# Autodesk Inventor assembly: V6_Heads_Valvetrain
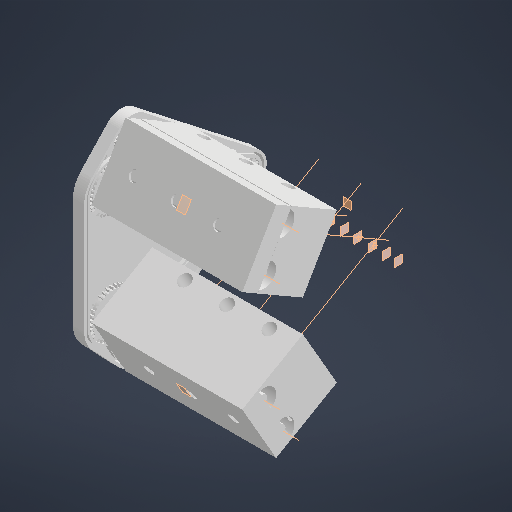
[picture p0: Inventor's stored thumbnail of the model, 512x512]
Saved by Autodesk Inventor 2027.1 (Build 311270010, 270A)
## iProperties
Created: 2026-10-17
Part Number: V6_Heads_Valvetrain
Document SubType Name: Assembly
Designer: kashyap
Author: kashyap
## Documents named in this file (20)
- C:\Users\kashyap\Documents\V6_2GR\V6_Heads_Valvetrain.iam
- C:\Users\kashyap\Documents\V6_2GR\Cylinder_Head_A.ipt
- C:\Users\kashyap\Documents\V6_2GR\Cylinder_Head_B.ipt
- C:\Users\kashyap\Documents\V6_2GR\Cam_Cover_A.ipt
- C:\Users\kashyap\Documents\V6_2GR\Cam_Cover_B.ipt
- C:\Users\kashyap\Documents\V6_2GR\Timing_Cover.ipt
- C:\Users\kashyap\Documents\V6_2GR\Timing_Chain_Primary_SIMPLIFIED.ipt
- C:\Users\kashyap\Documents\V6_2GR\Timing_Chain_Secondary_A_SIMPLIFIED.ipt
- C:\Users\kashyap\Documents\V6_2GR\Timing_Chain_Secondary_B_SIMPLIFIED.ipt
- C:\Users\kashyap\Documents\V6_2GR\Chain_Guide_SIMPLIFIED.ipt
- C:\Users\kashyap\Documents\V6_2GR\Chain_Tensioner_SIMPLIFIED.ipt
- C:\Users\kashyap\Documents\V6_2GR\Intake_Valve.ipt
- C:\Users\kashyap\Documents\V6_2GR\Exhaust_Valve.ipt
- C:\Users\kashyap\Documents\V6_2GR\Camshaft_A_Intake.ipt
- C:\Users\kashyap\Documents\V6_2GR\Camshaft_A_Exhaust.ipt
- C:\Users\kashyap\Documents\V6_2GR\Camshaft_B_Intake.ipt
- C:\Users\kashyap\Documents\V6_2GR\Camshaft_B_Exhaust.ipt
- C:\Users\kashyap\Documents\V6_2GR\Crank_Sprocket.ipt
- C:\Users\kashyap\Documents\V6_2GR\Cam_Sprocket_Primary.ipt
- C:\Users\kashyap\Documents\V6_2GR\Cam_Sprocket_Secondary.ipt
## Components (45 placed, 45 different names)
1. Cylinder_Head_A — Cylinder_Head_A_Flush_X, Cylinder_Head_A_Flush_Y, Cylinder_Head_A_Flush_Z, Valve_A1_IN_F_on_Axis, Valve_A1_IN_F_Seat_Mate, Valve_A1_IN_R_on_Axis, Valve_A1_IN_R_Seat_Mate, Valve_A1_EX_F_on_Axis, Valve_A1_EX_F_Seat_Mate, Valve_A1_EX_R_on_Axis, Valve_A1_EX_R_Seat_Mate, Valve_A2_IN_F_on_Axis, Valve_A2_IN_F_Seat_Mate_LIFT_AT_CRANK0, Valve_A2_IN_R_on_Axis, Valve_A2_IN_R_Seat_Mate_LIFT_AT_CRANK0, Valve_A2_EX_F_on_Axis, Valve_A2_EX_F_Seat_Mate, Valve_A2_EX_R_on_Axis, Valve_A2_EX_R_Seat_Mate, Valve_A3_IN_F_on_Axis, Valve_A3_IN_F_Seat_Mate, Valve_A3_IN_R_on_Axis, Valve_A3_IN_R_Seat_Mate, Valve_A3_EX_F_on_Axis, Valve_A3_EX_F_Seat_Mate_LIFT_AT_CRANK0, Valve_A3_EX_R_on_Axis, Valve_A3_EX_R_Seat_Mate_LIFT_AT_CRANK0, Camshaft_A_Intake_on_Cam_Axis, Camshaft_A_Intake_Phase_Angle_ASSUMED, Camshaft_A_Exhaust_on_Cam_Axis, Camshaft_A_Exhaust_Phase_Angle_ASSUMED
2. Cylinder_Head_B — Cylinder_Head_B_Flush_X, Cylinder_Head_B_Flush_Y, Cylinder_Head_B_Flush_Z, Valve_B1_IN_F_on_Axis, Valve_B1_IN_F_Seat_Mate, Valve_B1_IN_R_on_Axis, Valve_B1_IN_R_Seat_Mate, Valve_B1_EX_F_on_Axis, Valve_B1_EX_F_Seat_Mate, Valve_B1_EX_R_on_Axis, Valve_B1_EX_R_Seat_Mate, Valve_B2_IN_F_on_Axis, Valve_B2_IN_F_Seat_Mate, Valve_B2_IN_R_on_Axis, Valve_B2_IN_R_Seat_Mate, Valve_B2_EX_F_on_Axis, Valve_B2_EX_F_Seat_Mate, Valve_B2_EX_R_on_Axis, Valve_B2_EX_R_Seat_Mate, Valve_B3_IN_F_on_Axis, Valve_B3_IN_F_Seat_Mate, Valve_B3_IN_R_on_Axis, Valve_B3_IN_R_Seat_Mate, Valve_B3_EX_F_on_Axis, Valve_B3_EX_F_Seat_Mate, Valve_B3_EX_R_on_Axis, Valve_B3_EX_R_Seat_Mate, Camshaft_B_Intake_on_Cam_Axis, Camshaft_B_Intake_Phase_Angle_ASSUMED, Camshaft_B_Exhaust_on_Cam_Axis, Camshaft_B_Exhaust_Phase_Angle_ASSUMED
3. Cam_Cover_A — Cam_Cover_A_Flush_X, Cam_Cover_A_Flush_Y, Cam_Cover_A_Flush_Z
4. Cam_Cover_B — Cam_Cover_B_Flush_X, Cam_Cover_B_Flush_Y, Cam_Cover_B_Flush_Z
5. Timing_Cover — Timing_Cover_Flush_X, Timing_Cover_Flush_Y, Timing_Cover_Flush_Z, Crank_Sprocket_on_Axis, Crank_Sprocket_Plane_Flush, Cam_Sprocket_Primary_A_Plane_Flush, Cam_Sprocket_Secondary_A_Intake_Plane_Flush, Cam_Sprocket_Secondary_A_Exhaust_Plane_Flush, Cam_Sprocket_Primary_B_Plane_Flush, Cam_Sprocket_Secondary_B_Intake_Plane_Flush, Cam_Sprocket_Secondary_B_Exhaust_Plane_Flush
6. Timing_Chain_Primary_SIMPLIFIED — Timing_Chain_Primary_SIMPLIFIED_Flush_X, Timing_Chain_Primary_SIMPLIFIED_Flush_Y, Timing_Chain_Primary_SIMPLIFIED_Flush_Z
7. Timing_Chain_Secondary_A_SIMPLIFIED — Timing_Chain_Secondary_A_SIMPLIFIED_Flush_X, Timing_Chain_Secondary_A_SIMPLIFIED_Flush_Y, Timing_Chain_Secondary_A_SIMPLIFIED_Flush_Z
8. Timing_Chain_Secondary_B_SIMPLIFIED — Timing_Chain_Secondary_B_SIMPLIFIED_Flush_X, Timing_Chain_Secondary_B_SIMPLIFIED_Flush_Y, Timing_Chain_Secondary_B_SIMPLIFIED_Flush_Z
9. Chain_Guide_SIMPLIFIED — Chain_Guide_SIMPLIFIED_Flush_X, Chain_Guide_SIMPLIFIED_Flush_Y, Chain_Guide_SIMPLIFIED_Flush_Z
10. Chain_Tensioner_SIMPLIFIED — Chain_Tensioner_SIMPLIFIED_Flush_X, Chain_Tensioner_SIMPLIFIED_Flush_Y, Chain_Tensioner_SIMPLIFIED_Flush_Z
11. Valve_A1_IN_F — Valve_A1_IN_F_on_Axis, Valve_A1_IN_F_Seat_Mate
12. Valve_A1_IN_R — Valve_A1_IN_R_on_Axis, Valve_A1_IN_R_Seat_Mate
13. Valve_A1_EX_F — Valve_A1_EX_F_on_Axis, Valve_A1_EX_F_Seat_Mate
14. Valve_A1_EX_R — Valve_A1_EX_R_on_Axis, Valve_A1_EX_R_Seat_Mate
15. Valve_A2_IN_F — Valve_A2_IN_F_on_Axis, Valve_A2_IN_F_Seat_Mate_LIFT_AT_CRANK0
16. Valve_A2_IN_R — Valve_A2_IN_R_on_Axis, Valve_A2_IN_R_Seat_Mate_LIFT_AT_CRANK0
17. Valve_A2_EX_F — Valve_A2_EX_F_on_Axis, Valve_A2_EX_F_Seat_Mate
18. Valve_A2_EX_R — Valve_A2_EX_R_on_Axis, Valve_A2_EX_R_Seat_Mate
19. Valve_A3_IN_F — Valve_A3_IN_F_on_Axis, Valve_A3_IN_F_Seat_Mate
20. Valve_A3_IN_R — Valve_A3_IN_R_on_Axis, Valve_A3_IN_R_Seat_Mate
21. Valve_A3_EX_F — Valve_A3_EX_F_on_Axis, Valve_A3_EX_F_Seat_Mate_LIFT_AT_CRANK0
22. Valve_A3_EX_R — Valve_A3_EX_R_on_Axis, Valve_A3_EX_R_Seat_Mate_LIFT_AT_CRANK0
23. Valve_B1_IN_F — Valve_B1_IN_F_on_Axis, Valve_B1_IN_F_Seat_Mate
24. Valve_B1_IN_R — Valve_B1_IN_R_on_Axis, Valve_B1_IN_R_Seat_Mate
25. Valve_B1_EX_F — Valve_B1_EX_F_on_Axis, Valve_B1_EX_F_Seat_Mate
26. Valve_B1_EX_R — Valve_B1_EX_R_on_Axis, Valve_B1_EX_R_Seat_Mate
27. Valve_B2_IN_F — Valve_B2_IN_F_on_Axis, Valve_B2_IN_F_Seat_Mate
28. Valve_B2_IN_R — Valve_B2_IN_R_on_Axis, Valve_B2_IN_R_Seat_Mate
29. Valve_B2_EX_F — Valve_B2_EX_F_on_Axis, Valve_B2_EX_F_Seat_Mate
30. Valve_B2_EX_R — Valve_B2_EX_R_on_Axis, Valve_B2_EX_R_Seat_Mate
31. Valve_B3_IN_F — Valve_B3_IN_F_on_Axis, Valve_B3_IN_F_Seat_Mate
32. Valve_B3_IN_R — Valve_B3_IN_R_on_Axis, Valve_B3_IN_R_Seat_Mate
33. Valve_B3_EX_F — Valve_B3_EX_F_on_Axis, Valve_B3_EX_F_Seat_Mate
34. Valve_B3_EX_R — Valve_B3_EX_R_on_Axis, Valve_B3_EX_R_Seat_Mate
35. Camshaft_A_Intake — Camshaft_A_Intake_on_Cam_Axis, Camshaft_A_Intake_Axial_Flush, Camshaft_A_Intake_Phase_Angle_ASSUMED, Cam_Sprocket_Primary_A_on_Axis, Cam_Sprocket_Primary_A_Clock, Cam_Sprocket_Secondary_A_Intake_on_Axis, Cam_Sprocket_Secondary_A_Intake_Clock
36. Camshaft_A_Exhaust — Camshaft_A_Exhaust_on_Cam_Axis, Camshaft_A_Exhaust_Axial_Flush, Camshaft_A_Exhaust_Phase_Angle_ASSUMED, Cam_Sprocket_Secondary_A_Exhaust_on_Axis, Cam_Sprocket_Secondary_A_Exhaust_Clock
37. Camshaft_B_Intake — Camshaft_B_Intake_on_Cam_Axis, Camshaft_B_Intake_Axial_Flush, Camshaft_B_Intake_Phase_Angle_ASSUMED, Cam_Sprocket_Primary_B_on_Axis, Cam_Sprocket_Primary_B_Clock, Cam_Sprocket_Secondary_B_Intake_on_Axis, Cam_Sprocket_Secondary_B_Intake_Clock
38. Camshaft_B_Exhaust — Camshaft_B_Exhaust_on_Cam_Axis, Camshaft_B_Exhaust_Axial_Flush, Camshaft_B_Exhaust_Phase_Angle_ASSUMED, Cam_Sprocket_Secondary_B_Exhaust_on_Axis, Cam_Sprocket_Secondary_B_Exhaust_Clock
39. Crank_Sprocket — Crank_Sprocket_on_Axis, Crank_Sprocket_Plane_Flush, Crank_Sprocket_Clock
40. Cam_Sprocket_Primary_A — Cam_Sprocket_Primary_A_on_Axis, Cam_Sprocket_Primary_A_Plane_Flush, Cam_Sprocket_Primary_A_Clock
41. Cam_Sprocket_Secondary_A_Intake — Cam_Sprocket_Secondary_A_Intake_on_Axis, Cam_Sprocket_Secondary_A_Intake_Plane_Flush, Cam_Sprocket_Secondary_A_Intake_Clock
42. Cam_Sprocket_Secondary_A_Exhaust — Cam_Sprocket_Secondary_A_Exhaust_on_Axis, Cam_Sprocket_Secondary_A_Exhaust_Plane_Flush, Cam_Sprocket_Secondary_A_Exhaust_Clock
43. Cam_Sprocket_Primary_B — Cam_Sprocket_Primary_B_on_Axis, Cam_Sprocket_Primary_B_Plane_Flush, Cam_Sprocket_Primary_B_Clock
44. Cam_Sprocket_Secondary_B_Intake — Cam_Sprocket_Secondary_B_Intake_on_Axis, Cam_Sprocket_Secondary_B_Intake_Plane_Flush, Cam_Sprocket_Secondary_B_Intake_Clock
45. Cam_Sprocket_Secondary_B_Exhaust — Cam_Sprocket_Secondary_B_Exhaust_on_Axis, Cam_Sprocket_Secondary_B_Exhaust_Plane_Flush, Cam_Sprocket_Secondary_B_Exhaust_Clock
## Relationships (111: Mate 59, Flush 41, Angle 11)
- Cylinder_Head_A_Flush_X [Flush]: Cylinder_Head_A
- Cylinder_Head_A_Flush_Y [Flush]: Cylinder_Head_A
- Cylinder_Head_A_Flush_Z [Flush]: Cylinder_Head_A
- Cylinder_Head_B_Flush_X [Flush]: Cylinder_Head_B
- Cylinder_Head_B_Flush_Y [Flush]: Cylinder_Head_B
- Cylinder_Head_B_Flush_Z [Flush]: Cylinder_Head_B
- Cam_Cover_A_Flush_X [Flush]: Cam_Cover_A
- Cam_Cover_A_Flush_Y [Flush]: Cam_Cover_A
- Cam_Cover_A_Flush_Z [Flush]: Cam_Cover_A
- Cam_Cover_B_Flush_X [Flush]: Cam_Cover_B
- Cam_Cover_B_Flush_Y [Flush]: Cam_Cover_B
- Cam_Cover_B_Flush_Z [Flush]: Cam_Cover_B
- Timing_Cover_Flush_X [Flush]: Timing_Cover
- Timing_Cover_Flush_Y [Flush]: Timing_Cover
- Timing_Cover_Flush_Z [Flush]: Timing_Cover
- Timing_Chain_Primary_SIMPLIFIED_Flush_X [Flush]: Timing_Chain_Primary_SIMPLIFIED
- Timing_Chain_Primary_SIMPLIFIED_Flush_Y [Flush]: Timing_Chain_Primary_SIMPLIFIED
- Timing_Chain_Primary_SIMPLIFIED_Flush_Z [Flush]: Timing_Chain_Primary_SIMPLIFIED
- Timing_Chain_Secondary_A_SIMPLIFIED_Flush_X [Flush]: Timing_Chain_Secondary_A_SIMPLIFIED
- Timing_Chain_Secondary_A_SIMPLIFIED_Flush_Y [Flush]: Timing_Chain_Secondary_A_SIMPLIFIED
- Timing_Chain_Secondary_A_SIMPLIFIED_Flush_Z [Flush]: Timing_Chain_Secondary_A_SIMPLIFIED
- Timing_Chain_Secondary_B_SIMPLIFIED_Flush_X [Flush]: Timing_Chain_Secondary_B_SIMPLIFIED
- Timing_Chain_Secondary_B_SIMPLIFIED_Flush_Y [Flush]: Timing_Chain_Secondary_B_SIMPLIFIED
- Timing_Chain_Secondary_B_SIMPLIFIED_Flush_Z [Flush]: Timing_Chain_Secondary_B_SIMPLIFIED
- Chain_Guide_SIMPLIFIED_Flush_X [Flush]: Chain_Guide_SIMPLIFIED
- Chain_Guide_SIMPLIFIED_Flush_Y [Flush]: Chain_Guide_SIMPLIFIED
- Chain_Guide_SIMPLIFIED_Flush_Z [Flush]: Chain_Guide_SIMPLIFIED
- Chain_Tensioner_SIMPLIFIED_Flush_X [Flush]: Chain_Tensioner_SIMPLIFIED
- Chain_Tensioner_SIMPLIFIED_Flush_Y [Flush]: Chain_Tensioner_SIMPLIFIED
- Chain_Tensioner_SIMPLIFIED_Flush_Z [Flush]: Chain_Tensioner_SIMPLIFIED
- Valve_A1_IN_F_on_Axis [Mate]: Cylinder_Head_A ↔ Valve_A1_IN_F
- Valve_A1_IN_F_Seat_Mate [Mate]: Cylinder_Head_A ↔ Valve_A1_IN_F
- Valve_A1_IN_R_on_Axis [Mate]: Cylinder_Head_A ↔ Valve_A1_IN_R
- Valve_A1_IN_R_Seat_Mate [Mate]: Cylinder_Head_A ↔ Valve_A1_IN_R
- Valve_A1_EX_F_on_Axis [Mate]: Cylinder_Head_A ↔ Valve_A1_EX_F
- Valve_A1_EX_F_Seat_Mate [Mate]: Cylinder_Head_A ↔ Valve_A1_EX_F
- Valve_A1_EX_R_on_Axis [Mate]: Cylinder_Head_A ↔ Valve_A1_EX_R
- Valve_A1_EX_R_Seat_Mate [Mate]: Cylinder_Head_A ↔ Valve_A1_EX_R
- Valve_A2_IN_F_on_Axis [Mate]: Cylinder_Head_A ↔ Valve_A2_IN_F
- Valve_A2_IN_F_Seat_Mate_LIFT_AT_CRANK0 [Mate] (9.228 mm): Cylinder_Head_A ↔ Valve_A2_IN_F
- Valve_A2_IN_R_on_Axis [Mate]: Cylinder_Head_A ↔ Valve_A2_IN_R
- Valve_A2_IN_R_Seat_Mate_LIFT_AT_CRANK0 [Mate] (9.228 mm): Cylinder_Head_A ↔ Valve_A2_IN_R
- Valve_A2_EX_F_on_Axis [Mate]: Cylinder_Head_A ↔ Valve_A2_EX_F
- Valve_A2_EX_F_Seat_Mate [Mate]: Cylinder_Head_A ↔ Valve_A2_EX_F
- Valve_A2_EX_R_on_Axis [Mate]: Cylinder_Head_A ↔ Valve_A2_EX_R
- Valve_A2_EX_R_Seat_Mate [Mate]: Cylinder_Head_A ↔ Valve_A2_EX_R
- Valve_A3_IN_F_on_Axis [Mate]: Cylinder_Head_A ↔ Valve_A3_IN_F
- Valve_A3_IN_F_Seat_Mate [Mate]: Cylinder_Head_A ↔ Valve_A3_IN_F
- Valve_A3_IN_R_on_Axis [Mate]: Cylinder_Head_A ↔ Valve_A3_IN_R
- Valve_A3_IN_R_Seat_Mate [Mate]: Cylinder_Head_A ↔ Valve_A3_IN_R
- Valve_A3_EX_F_on_Axis [Mate]: Cylinder_Head_A ↔ Valve_A3_EX_F
- Valve_A3_EX_F_Seat_Mate_LIFT_AT_CRANK0 [Mate] (9.24 mm): Cylinder_Head_A ↔ Valve_A3_EX_F
- Valve_A3_EX_R_on_Axis [Mate]: Cylinder_Head_A ↔ Valve_A3_EX_R
- Valve_A3_EX_R_Seat_Mate_LIFT_AT_CRANK0 [Mate] (9.24 mm): Cylinder_Head_A ↔ Valve_A3_EX_R
- Valve_B1_IN_F_on_Axis [Mate]: Cylinder_Head_B ↔ Valve_B1_IN_F
- Valve_B1_IN_F_Seat_Mate [Mate]: Cylinder_Head_B ↔ Valve_B1_IN_F
- Valve_B1_IN_R_on_Axis [Mate]: Cylinder_Head_B ↔ Valve_B1_IN_R
- Valve_B1_IN_R_Seat_Mate [Mate]: Cylinder_Head_B ↔ Valve_B1_IN_R
- Valve_B1_EX_F_on_Axis [Mate]: Cylinder_Head_B ↔ Valve_B1_EX_F
- Valve_B1_EX_F_Seat_Mate [Mate]: Cylinder_Head_B ↔ Valve_B1_EX_F
- Valve_B1_EX_R_on_Axis [Mate]: Cylinder_Head_B ↔ Valve_B1_EX_R
- Valve_B1_EX_R_Seat_Mate [Mate]: Cylinder_Head_B ↔ Valve_B1_EX_R
- Valve_B2_IN_F_on_Axis [Mate]: Cylinder_Head_B ↔ Valve_B2_IN_F
- Valve_B2_IN_F_Seat_Mate [Mate]: Cylinder_Head_B ↔ Valve_B2_IN_F
- Valve_B2_IN_R_on_Axis [Mate]: Cylinder_Head_B ↔ Valve_B2_IN_R
- Valve_B2_IN_R_Seat_Mate [Mate]: Cylinder_Head_B ↔ Valve_B2_IN_R
- Valve_B2_EX_F_on_Axis [Mate]: Cylinder_Head_B ↔ Valve_B2_EX_F
- Valve_B2_EX_F_Seat_Mate [Mate]: Cylinder_Head_B ↔ Valve_B2_EX_F
- Valve_B2_EX_R_on_Axis [Mate]: Cylinder_Head_B ↔ Valve_B2_EX_R
- Valve_B2_EX_R_Seat_Mate [Mate]: Cylinder_Head_B ↔ Valve_B2_EX_R
- Valve_B3_IN_F_on_Axis [Mate]: Cylinder_Head_B ↔ Valve_B3_IN_F
- Valve_B3_IN_F_Seat_Mate [Mate]: Cylinder_Head_B ↔ Valve_B3_IN_F
- Valve_B3_IN_R_on_Axis [Mate]: Cylinder_Head_B ↔ Valve_B3_IN_R
- Valve_B3_IN_R_Seat_Mate [Mate]: Cylinder_Head_B ↔ Valve_B3_IN_R
- Valve_B3_EX_F_on_Axis [Mate]: Cylinder_Head_B ↔ Valve_B3_EX_F
- Valve_B3_EX_F_Seat_Mate [Mate]: Cylinder_Head_B ↔ Valve_B3_EX_F
- Valve_B3_EX_R_on_Axis [Mate]: Cylinder_Head_B ↔ Valve_B3_EX_R
- Valve_B3_EX_R_Seat_Mate [Mate]: Cylinder_Head_B ↔ Valve_B3_EX_R
- Camshaft_A_Intake_on_Cam_Axis [Mate]: Cylinder_Head_A ↔ Camshaft_A_Intake
- Camshaft_A_Intake_Axial_Flush [Flush]: Camshaft_A_Intake
- Camshaft_A_Intake_Phase_Angle_ASSUMED [Angle] (0 deg): Cylinder_Head_A ↔ Camshaft_A_Intake
- Camshaft_A_Exhaust_on_Cam_Axis [Mate]: Cylinder_Head_A ↔ Camshaft_A_Exhaust
- Camshaft_A_Exhaust_Axial_Flush [Flush]: Camshaft_A_Exhaust
- Camshaft_A_Exhaust_Phase_Angle_ASSUMED [Angle] (0 deg): Cylinder_Head_A ↔ Camshaft_A_Exhaust
- Camshaft_B_Intake_on_Cam_Axis [Mate]: Cylinder_Head_B ↔ Camshaft_B_Intake
- Camshaft_B_Intake_Axial_Flush [Flush]: Camshaft_B_Intake
- Camshaft_B_Intake_Phase_Angle_ASSUMED [Angle] (0 deg): Cylinder_Head_B ↔ Camshaft_B_Intake
- Camshaft_B_Exhaust_on_Cam_Axis [Mate]: Cylinder_Head_B ↔ Camshaft_B_Exhaust
- Camshaft_B_Exhaust_Axial_Flush [Flush]: Camshaft_B_Exhaust
- Camshaft_B_Exhaust_Phase_Angle_ASSUMED [Angle] (0 deg): Cylinder_Head_B ↔ Camshaft_B_Exhaust
- Crank_Sprocket_on_Axis [Mate]: Timing_Cover ↔ Crank_Sprocket
- Crank_Sprocket_Plane_Flush [Flush]: Timing_Cover ↔ Crank_Sprocket
- Crank_Sprocket_Clock [Angle] (0 deg): Crank_Sprocket
- Cam_Sprocket_Primary_A_on_Axis [Mate]: Camshaft_A_Intake ↔ Cam_Sprocket_Primary_A
- Cam_Sprocket_Primary_A_Plane_Flush [Flush]: Timing_Cover ↔ Cam_Sprocket_Primary_A
- Cam_Sprocket_Primary_A_Clock [Angle] (0 deg): Camshaft_A_Intake ↔ Cam_Sprocket_Primary_A
- Cam_Sprocket_Secondary_A_Intake_on_Axis [Mate]: Camshaft_A_Intake ↔ Cam_Sprocket_Secondary_A_Intake
- Cam_Sprocket_Secondary_A_Intake_Plane_Flush [Flush]: Timing_Cover ↔ Cam_Sprocket_Secondary_A_Intake
- Cam_Sprocket_Secondary_A_Intake_Clock [Angle] (0 deg): Camshaft_A_Intake ↔ Cam_Sprocket_Secondary_A_Intake
- Cam_Sprocket_Secondary_A_Exhaust_on_Axis [Mate]: Camshaft_A_Exhaust ↔ Cam_Sprocket_Secondary_A_Exhaust
- Cam_Sprocket_Secondary_A_Exhaust_Plane_Flush [Flush]: Timing_Cover ↔ Cam_Sprocket_Secondary_A_Exhaust
- Cam_Sprocket_Secondary_A_Exhaust_Clock [Angle] (0 deg): Camshaft_A_Exhaust ↔ Cam_Sprocket_Secondary_A_Exhaust
- Cam_Sprocket_Primary_B_on_Axis [Mate]: Camshaft_B_Intake ↔ Cam_Sprocket_Primary_B
- Cam_Sprocket_Primary_B_Plane_Flush [Flush]: Timing_Cover ↔ Cam_Sprocket_Primary_B
- Cam_Sprocket_Primary_B_Clock [Angle] (0 deg): Camshaft_B_Intake ↔ Cam_Sprocket_Primary_B
- Cam_Sprocket_Secondary_B_Intake_on_Axis [Mate]: Camshaft_B_Intake ↔ Cam_Sprocket_Secondary_B_Intake
- Cam_Sprocket_Secondary_B_Intake_Plane_Flush [Flush]: Timing_Cover ↔ Cam_Sprocket_Secondary_B_Intake
- Cam_Sprocket_Secondary_B_Intake_Clock [Angle] (0 deg): Camshaft_B_Intake ↔ Cam_Sprocket_Secondary_B_Intake
- Cam_Sprocket_Secondary_B_Exhaust_on_Axis [Mate]: Camshaft_B_Exhaust ↔ Cam_Sprocket_Secondary_B_Exhaust
- Cam_Sprocket_Secondary_B_Exhaust_Plane_Flush [Flush]: Timing_Cover ↔ Cam_Sprocket_Secondary_B_Exhaust
- Cam_Sprocket_Secondary_B_Exhaust_Clock [Angle] (0 deg): Camshaft_B_Exhaust ↔ Cam_Sprocket_Secondary_B_Exhaust
